# Autodesk Inventor assembly: Robotic Arm_ASSEMBLY
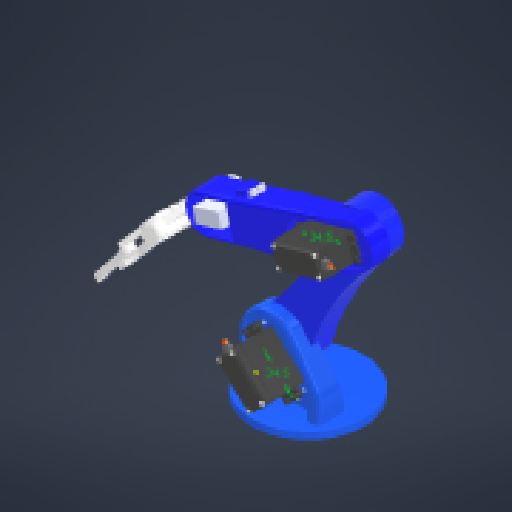
[picture p0: Inventor's stored thumbnail of the model, 512x512]
Saved by Autodesk Inventor 2026.2 (Build 302298000, 298)
## iProperties
Created: 2021-03-01
Part Number: Robotic Arm_ASSEMBLY
Document SubType Name: Assembly
Designer: thita
Sending System: SOLIDWORKS 2020
Last Saved Date: 2021-08-25
last saved by: jinwo
Author: thita
## Documents named in this file (9)
- C:\Users\thita\Downloads\robotic-arm-273.snapshot.15\Robotic Arm_ASSEMBLY\Robotic Arm_ASSEMBLY\Robotic Arm_ASSEMBLY.iam
- C:\Users\thita\Downloads\robotic-arm-273.snapshot.15\Robotic Arm_ASSEMBLY\Robotic Arm_ASSEMBLY\Arm2.ipt
- C:\Users\thita\Downloads\robotic-arm-273.snapshot.15\Robotic Arm_ASSEMBLY\Robotic Arm_ASSEMBLY\Arm3.ipt
- C:\Users\thita\Downloads\robotic-arm-273.snapshot.15\Robotic Arm_ASSEMBLY\Robotic Arm_ASSEMBLY\Waist.ipt
- C:\Users\thita\Downloads\robotic-arm-273.snapshot.15\Robotic Arm_ASSEMBLY\Robotic Arm_ASSEMBLY\Arm1.ipt
- C:\Users\thita\Downloads\robotic-arm-273.snapshot.15\Robotic Arm_ASSEMBLY\Robotic Arm_ASSEMBLY\Gripper Assembly.iam
- C:\Users\thita\Downloads\robotic-arm-273.snapshot.15\Robotic Arm_ASSEMBLY\Robotic Arm_ASSEMBLY\SG90.iam
- C:\Users\thita\Downloads\robotic-arm-273.snapshot.15\Robotic Arm_ASSEMBLY\Robotic Arm_ASSEMBLY\MG996R.iam
- C:\Users\thita\Robot yến\File thiết kế 3D\tay gắp yến\thanh nối new.ipt
## Components (10 placed, 10 different names)
1. Arm2-1 — Mate:6, Mate:7, Mate:8, Mate:10, Mate:11
2. Arm3-1 — Mate:9, Mate:10, Mate:11
3. Waist-1 — Mate:4
4. Arm1-2
5. Gripper Assembly-1 [sub-assembly] — Mate:12
6. SG90-1 [sub-assembly] — Mate:7, Mate:8
7. SG90-3 [sub-assembly] — Mate:9, Mate:12
8. MG996R-2 [sub-assembly] — Insert:1
9. MG996R-3 [sub-assembly] — Mate:4, Mate:5
10. thanh nối new:1 — Mate:5, Mate:6, Insert:1
## Relationships (10: Mate 9, Insert 1)
- Mate:4: Waist-1 ↔ MG996R-3
- Mate:5: MG996R-3 ↔ thanh nối new:1
- Mate:6: Arm2-1 ↔ thanh nối new:1
- Insert:1: MG996R-2 ↔ thanh nối new:1
- Mate:7: Arm2-1 ↔ SG90-1
- Mate:8: Arm2-1 ↔ SG90-1
- Mate:9: Arm3-1 ↔ SG90-3
- Mate:10: Arm2-1 ↔ Arm3-1
- Mate:11: Arm2-1 ↔ Arm3-1
- Mate:12: Gripper Assembly-1 ↔ SG90-3
